# Autodesk Inventor assembly: ASY DMF-1600 Front Connector
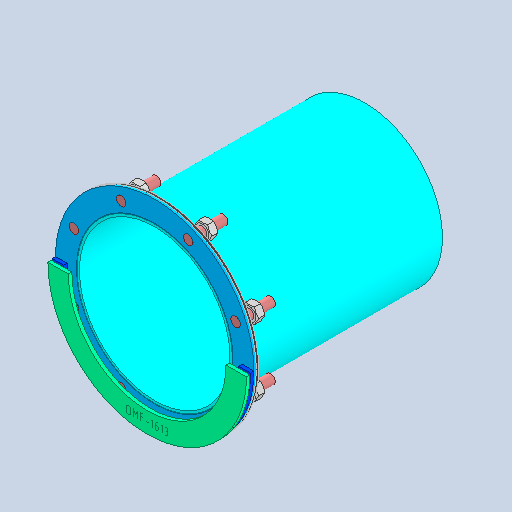
[picture p0: Inventor's stored thumbnail of the model, 512x512]
Saved by Autodesk Inventor 2026.2 (Build 302298000, 298)
## iProperties
Created: 2026-11-14
Part Number: ASY DMF-1600 Front Connector
Document SubType Name: Assembly
Designer: admin
Stock Number: DMF-1600
Author: admin
## Documents named in this file (8)
- C:\Users\admin\Documents\Inventor\DMF-Disk-Micro-Filter\ASY DMF-1600 Front Connector.iam
- C:\Users\admin\Documents\Inventor\DMF-Disk-Micro-Filter\Барабан v2.1\DMF-1614 Connector Ring.ipt
- C:\Users\admin\Documents\Inventor\DMF-Disk-Micro-Filter\DMF-1615 Connector Tube.ipt
- C:\Users\admin\Documents\Inventor\DMF-Disk-Micro-Filter\DMF-4202 Stud 02.ipt
- C:\Users\admin\Documents\Inventor\DMF-Disk-Micro-Filter\Барабан v2.1\DMF-1611 Front Connector Rubber Seal.ipt
- C:\Users\admin\Documents\Inventor\DMF-Disk-Micro-Filter\Барабан v2.1\DMF-1612 Front Connector Ring 2 Half.ipt
- C:\Users\admin\Documents\Inventor\DMF-Disk-Micro-Filter\ContentCenter\en-US\DIN EN ISO 4032\DIN EN ISO 4032 - M8.ipt
- C:\Users\admin\Documents\Inventor\DMF-Disk-Micro-Filter\Барабан v2.1\DMF-1613 Front Connector Ring 3 Half.ipt
## Components (21 placed, 7 different names)
1. DMF-1xxx :1 — Rigid:1, Flush:1, Flush:2, Flush:3, Rigid:2, Rigid:3, Rigid:4, Rigid:5, Rigid:6, Rigid:7, Rigid:8, Rigid:9, Rigid:10, Rigid:18
2. DMF-1615 Connector Tube:1 — Rigid:1
3. DMF-4202 Stud 02:1 — Rigid:4, Rigid:11
4. DMF-4202 Stud 02:2 — Rigid:5, Rigid:15
5. DMF-4202 Stud 02:3 — Rigid:6, Rigid:16
6. DMF-4202 Stud 02:4 — Rigid:10
7. DMF-4202 Stud 02:5 — Rigid:9, Rigid:13
8. DMF-4202 Stud 02:6 — Rigid:3, Rigid:12
9. DMF-4202 Stud 02:7 — Rigid:7, Rigid:17
10. DMF-4202 Stud 02:8 — Rigid:8, Rigid:14
11. DMF-1611 Front Connector Rubber Seal:1 — Rigid:18
12. DMF-1612 Front Connector Ring 2 Half:1 — Rigid:2
13. DIN EN ISO 4032 M8:1
14. DIN EN ISO 4032 M8:2 — Rigid:11
15. DIN EN ISO 4032 M8:3 — Rigid:12
16. DIN EN ISO 4032 M8:4 — Rigid:14
17. DIN EN ISO 4032 M8:5 — Rigid:13
18. DIN EN ISO 4032 M8:6 — Rigid:17
19. DIN EN ISO 4032 M8:7 — Rigid:16
20. DIN EN ISO 4032 M8:8 — Rigid:15
21. DMF-1613 Front Connector Ring 3 Half:1
## Relationships (22: WeldJoint 18, Flush 3, CylindricalJoint 1)
- Rigid:1 [WeldJoint]: DMF-1xxx :1 ↔ DMF-1615 Connector Tube:1
- Flush:1: DMF-1xxx :1
- Flush:2: DMF-1xxx :1
- Flush:3: DMF-1xxx :1
- Rigid:2 [WeldJoint]: DMF-1xxx :1 ↔ DMF-1612 Front Connector Ring 2 Half:1
- Rigid:3 [WeldJoint]: DMF-1xxx :1 ↔ DMF-4202 Stud 02:6
- Rigid:4 [WeldJoint]: DMF-1xxx :1 ↔ DMF-4202 Stud 02:1
- Rigid:5 [WeldJoint]: DMF-1xxx :1 ↔ DMF-4202 Stud 02:2
- Rigid:6 [WeldJoint]: DMF-1xxx :1 ↔ DMF-4202 Stud 02:3
- Rigid:7 [WeldJoint]: DMF-1xxx :1 ↔ DMF-4202 Stud 02:7
- Rigid:8 [WeldJoint]: DMF-1xxx :1 ↔ DMF-4202 Stud 02:8
- Rigid:9 [WeldJoint]: DMF-1xxx :1 ↔ DMF-4202 Stud 02:5
- Rigid:10 [WeldJoint]: DMF-1xxx :1 ↔ DMF-4202 Stud 02:4
- [CylindricalJoint]: DMF-4202 Stud 02:4 ↔ DIN EN ISO 4032 M8:1
- Rigid:11 [WeldJoint]: DMF-4202 Stud 02:1 ↔ DIN EN ISO 4032 M8:2
- Rigid:12 [WeldJoint]: DMF-4202 Stud 02:6 ↔ DIN EN ISO 4032 M8:3
- Rigid:13 [WeldJoint]: DMF-4202 Stud 02:5 ↔ DIN EN ISO 4032 M8:5
- Rigid:14 [WeldJoint]: DMF-4202 Stud 02:8 ↔ DIN EN ISO 4032 M8:4
- Rigid:15 [WeldJoint]: DMF-4202 Stud 02:2 ↔ DIN EN ISO 4032 M8:8
- Rigid:16 [WeldJoint]: DMF-4202 Stud 02:3 ↔ DIN EN ISO 4032 M8:7
- Rigid:17 [WeldJoint]: DMF-4202 Stud 02:7 ↔ DIN EN ISO 4032 M8:6
- Rigid:18 [WeldJoint]: DMF-1xxx :1 ↔ DMF-1611 Front Connector Rubber Seal:1
